# Autodesk Inventor assembly: disc 3
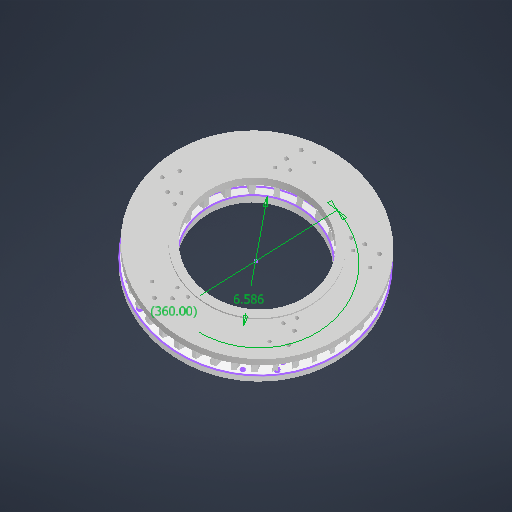
[picture p0: Inventor's stored thumbnail of the model, 512x512]
Saved by Autodesk Inventor 2027 (Build 310192060, 192F)
## iProperties
Created: 2026-07-10
Part Number: disc 3
Document SubType Name: Assembly
Designer: ElieH
Author: ElieH
## Documents named in this file (4)
- C:\Users\ElieH\Desktop\New folder (3)\disc 3.iam
- C:\Users\ElieH\Desktop\New folder (3)\cooling fins.ipt
- C:\Users\ElieH\Desktop\disks\disc3 front face side.ipt
- C:\Users\ElieH\Desktop\disks\disk back mod.ipt
## Components (3 placed, 3 different names)
1. cooling fins:1 — Mate:1, Mate:2, Mate:3, Mate:4
2. disc3 front face side:1 — Mate:3, Mate:4
3. disk back mod:1 — Mate:1, Mate:2
## Relationships (4: Mate 4)
- Mate:1: cooling fins:1 ↔ disk back mod:1
- Mate:2: cooling fins:1 ↔ disk back mod:1
- Mate:3: cooling fins:1 ↔ disc3 front face side:1
- Mate:4: cooling fins:1 ↔ disc3 front face side:1
